# Autodesk Inventor assembly: Hop_co_servo
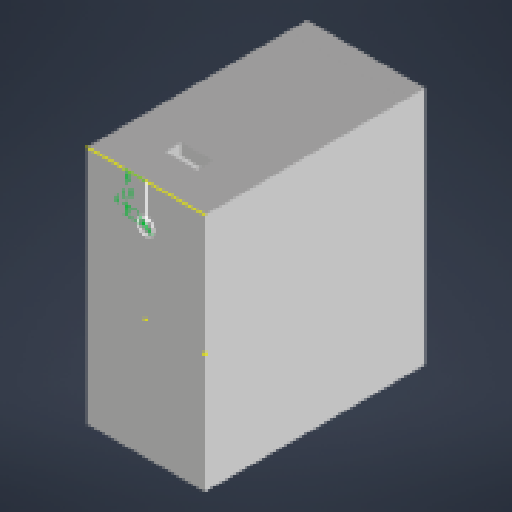
[picture p0: Inventor's stored thumbnail of the model, 512x512]
Saved by Autodesk Inventor 2027 (Build 310192060, 192F)
## iProperties
Created: 2026-04-03
Part Number: Hop_co_servo
Document SubType Name: Assembly
Designer: thita
Author: thita
## Documents named in this file (3)
- C:\Users\thita\ROBOT CÁ\ROBOTFISH_FINAL1\DESIGN\Workgroups\NotInProject\Hop_co_servo.iam
- C:\Users\thita\ROBOT CÁ\ROBOTFISH_FINAL1\DESIGN\Workgroups\NotInProject\Hộp khớp 2.ipt
- C:\Users\thita\ROBOT CÁ\ROBOTFISH_FINAL1\DESIGN\Workgroups\NotInProject\nắp.ipt
## Components (2 placed, 2 different names)
1. Hộp khớp 2:1 — Rigid:1
2. nắp:1 — Rigid:1
## Relationships (1: WeldJoint 1)
- Rigid:1 [WeldJoint]: Hộp khớp 2:1 ↔ nắp:1
